# Autodesk Inventor assembly: 4444 RP-496x1246x44
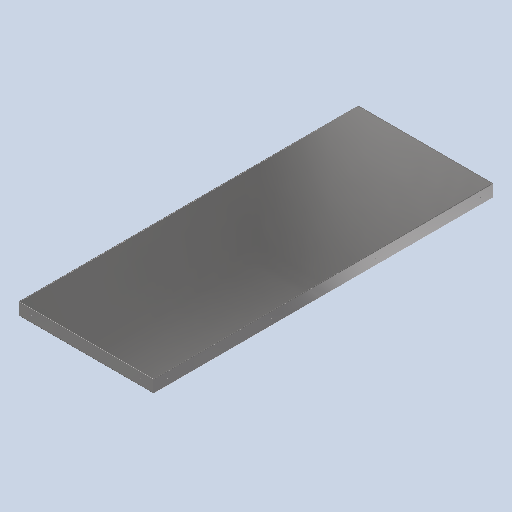
[picture p0: Inventor's stored thumbnail of the model, 512x512]
Saved by Autodesk Inventor 2024.4 (Build 284460030, 460C)
## iProperties
RuleStatus: InUse
Created: 2019-06-24
Part Number: 4444 RP-496x1246x44
Material: Generisch
Document SubType Name: Assembly
Designer: MK
Mass: 7951.34 g
Surface Area: 19876 cm^2
Volume: 1114.4 cm^3
Density: 7.13511 g/cm^3
Description: Tür-Paneel
InventorSizerSetup: RP 1T 1
Author: MK
## Documents named in this file (4)
- C:\Users\ahmad\OneDrive\Desktop\Inventor_Sizer\C# Version\GR\Einzelteile\4444 RP-496x1246x44.iam
- C:\Users\ahmad\OneDrive\Desktop\Inventor_Sizer\C# Version\GR\Einzelteile\4444 496x1246x44-Au.ipt
- C:\Users\ahmad\OneDrive\Desktop\Inventor_Sizer\C# Version\GR\Einzelteile\4444 496x1246x44-In.ipt
- C:\Users\ahmad\OneDrive\Desktop\Inventor_Sizer\C# Version\masters\RP\1T\MFG1000000.ipt
## Components (4 placed, 3 different names)
1. 4444 496x1246x44-Au:1 — Mate:6, Mate:7, Mate:8, Mate:9, Mate:10, Mate:11
2. 4444 496x1246x44-In:1 — Mate:6, Mate:7, Mate:8
3. MFG1000000:1 — Mate:9, Mate:10, Mate:11
4. MFG1000000:2
## Component patterns: (2 elements, first: MFG1000000:1)
## Relationships (6: Mate 6)
- Mate:6: 4444 496x1246x44-Au:1 ↔ 4444 496x1246x44-In:1
- Mate:7 (0.5 mm): 4444 496x1246x44-Au:1 ↔ 4444 496x1246x44-In:1
- Mate:8 (0.5 mm): 4444 496x1246x44-Au:1 ↔ 4444 496x1246x44-In:1
- Mate:9: 4444 496x1246x44-Au:1 ↔ MFG1000000:1
- Mate:10: 4444 496x1246x44-Au:1 ↔ MFG1000000:1
- Mate:11: 4444 496x1246x44-Au:1 ↔ MFG1000000:1
## Named parameters: Clearance = 0.5 mm, HingeCount = 2, HingePitch = 537 mm, HandleCount = 2, HandlePitch = 623 mm, Width = 496 mm, HandlePitchL = 623 mm, HandlePitchW = 0 mm, HandleDir = 0, HandleRef = 1246 mm, HandleCountL = 2, HandleCountW = 1, Length = 1246 mm
